# Autodesk Inventor assembly: 1-1
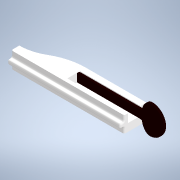
[picture p0: Inventor's stored thumbnail of the model, 180x180]
Saved by Autodesk Inventor 2020 (Build 240168000, 168)
## iProperties
Created: 2022-06-23
Part Number: 1-1
Document SubType Name: Assembly
Designer: drago
Author: drago
## Documents named in this file (3)
- C:\Users\drago\Documents\ULTIMA_VARIANTA\chei\1-1.iam
- C:\Users\drago\Documents\ULTIMA_VARIANTA\chei\cheie_v1_corect.ipt
- C:\Users\drago\Documents\ULTIMA_VARIANTA\Broasca\Broascav1\P2_V1_001.ipt
## Components (2 placed, 2 different names)
1. cheie_v1_corect:1 — Mate:1, Mate:2, Mate:3
2. P2_V1_001:1 — Mate:1, Mate:2, Mate:3
## Relationships (3: Mate 3)
- Mate:1: cheie_v1_corect:1 ↔ P2_V1_001:1
- Mate:2: cheie_v1_corect:1 ↔ P2_V1_001:1
- Mate:3: cheie_v1_corect:1 ↔ P2_V1_001:1
